# Autodesk Inventor assembly: DM-J10010l
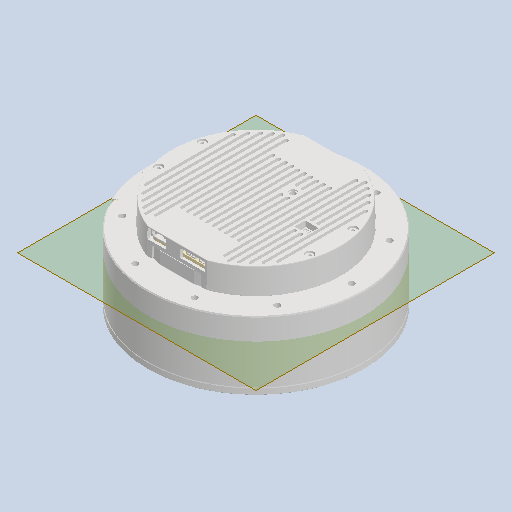
[picture p0: Inventor's stored thumbnail of the model, 512x512]
Saved by Autodesk Inventor 2025.3 (Build 293356000, 356)
## iProperties
Created: 2024-07-30
Part Number: DM-J10010l
Description: STEP AP203
Document SubType Name: Assembly
Designer: Admin
Sending System: SolidWorks 2022
Preprocessor: SwSTEP 2.0
Title: dm-j10010l-0730_1.STEP
Revision Number: ÈÎºÎ
## Documents named in this file (3)
- C:\Users\shfzf\Desktop\FEIBOT\ROBOT_CAD\DM-J10010l\DM-J10010l.iam
- C:\Users\shfzf\Desktop\FEIBOT\ROBOT_CAD\DM-J10010l\dm-j10010l-0730_1.stp.iam
- dm-j10010l-0730_1.stp
## Components (1 placed, 1 different names)
1. dm-j10010l-0730_1.stp_1 [sub-assembly] — 表面齐平:1
## Relationships (1: Flush 1)
- 表面齐平:1 [Flush] (-26.35 mm): dm-j10010l-0730_1.stp_1
